# Autodesk Inventor assembly: pl_v1
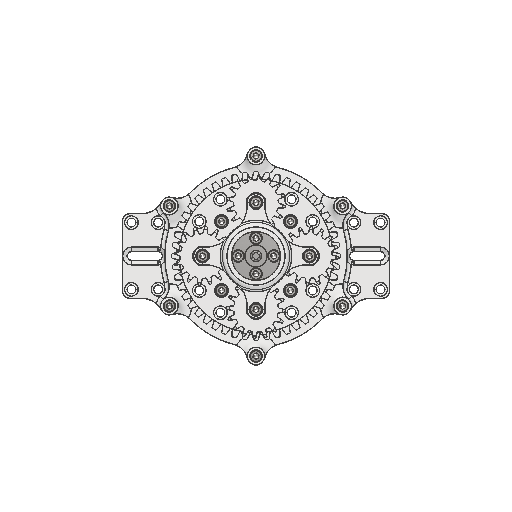
[picture p0: Inventor's stored thumbnail of the model, 512x512]
Saved by Autodesk Inventor 2027 (Build 310192000, 192)
## iProperties
Created: 2026-03-26
Part Number: pl_v1
Document SubType Name: Assembly
Designer: work
Mass: 713.416 g
Surface Area: 800.721 cm^2
Volume: 179.506 cm^3
Density: 3.97433 g/cm^3
Author: work
## Documents named in this file (13)
- C:\Users\khw\Desktop\ARD_v1\ARD_hardware\PL121248m2Drive_v2\pl_v1.iam
- C:\Users\khw\Desktop\ARD_v1\ARD_hardware\PL121248m2Drive_v2\gear_M1.5_Z16_H10.0_spur (1).ipt
- C:\Users\khw\Desktop\ARD_v1\ARD_hardware\PL121248m2Drive_v2\gear_M1.5_Z16_H10.0_spur.ipt
- C:\Users\khw\Desktop\ARD_v1\ARD_hardware\PL121248m2Drive_v2\gear_M1.5_Z48_H10.0_spur.ipt
- C:\Users\khw\Desktop\ARD_v1\ARD_hardware\PL121248m2Drive_v2\KS B 1003 - M 3 x 10.ipt
- C:\Users\khw\Desktop\ARD_v1\ARD_hardware\PL121248m2Drive_v2\NEMA17.ipt
- C:\Users\khw\Desktop\ARD_v1\ARD_hardware\PL121248m2Drive_v2\roter.ipt
- C:\Users\khw\Desktop\ARD_v1\ARD_hardware\PL121248m2Drive_v2\case.ipt
- C:\Users\khw\Desktop\ARD_v1\ARD_hardware\PL121248m2Drive_v2\KS B 1003 - M 3 x 12.ipt
- C:\Users\khw\Desktop\ARD_v1\ARD_hardware\ARD_Model_v1\KS B 2023 - 693 - 3 x 8 x 3 - 0.293.ipt
- C:\Users\khw\Desktop\ARD_v1\ARD_hardware\ARD_Model_v1\KS B 2023 - 6906 - 30 x 47 x 9 - 7.868.ipt
- C:\Users\khw\Desktop\ARD_v1\ARD_hardware\PL121248m2Drive_v2\5_Co.ipt
- C:\Users\khw\Desktop\ARD_v1\ARD_hardware\PL121248m2Drive_v2\5pi40pin.ipt
## Components (40 placed, 12 different names)
1. gear_M1.5_Z16_H10.0_spur (1):1 — 플러쉬:1, 메이트:10, 회전:2, 회전:10, 메이트:19, 메이트:20, 회전:6
2. gear_M1.5_Z16_H10.0_spur:1 — 플러쉬:2, 메이트:4, 메이트:11, 회전:2, 회전:4
3. gear_M1.5_Z48_H10.0_spur:1 — 메이트:1, 메이트:2, 메이트:3, 회전:1, 플러쉬:1, 플러쉬:2, 메이트:16, 각도:1, 플러쉬:3, 플러쉬:4, 플러쉬:5, 메이트:30, 메이트:32, 메이트:33, 각도:2
4. NEMA17:1 — 메이트:1, 메이트:2, 메이트:3, 메이트:4, 메이트:18
5. case:1 — 메이트:16, 메이트:17, 회전:5, 회전:6, 회전:8, 회전:9, 강체:1, 메이트:30, 메이트:32, 메이트:33, 삽입:1, 삽입:6, 삽입:7, 삽입:8, 삽입:9, 삽입:10
6. roter:1 — 메이트:10, 메이트:11, 회전:4, 메이트:17, 각도:1, 메이트:18, 회전:11, 메이트:20, 메이트:24, 메이트:25, 메이트:26, 플러쉬:6, 플러쉬:7, 플러쉬:8, 메이트:27, 메이트:28, 메이트:34, 메이트:35, 메이트:36, 메이트:38, 각도:2, 회전:5, 회전:6, 회전:7, 회전:8
7. KS B 2023 - 693 - 3 x 8 x 3 - 0.293:1 — 회전:10
8. KS B 1003 - M 3 x 12:7 — 회전:11, 메이트:19
9. gear_M1.5_Z16_H10.0_spur (1):2 — 플러쉬:5, 회전:7
10. KS B 2023 - 693 - 3 x 8 x 3 - 0.293:2
11. KS B 1003 - M 3 x 12:8 — 메이트:24, 플러쉬:7
12. gear_M1.5_Z16_H10.0_spur (1):3 — 플러쉬:3, 메이트:25, 회전:8
13. KS B 2023 - 693 - 3 x 8 x 3 - 0.293:3
14. KS B 1003 - M 3 x 12:9 — 플러쉬:6
15. gear_M1.5_Z16_H10.0_spur (1):4 — 플러쉬:4, 메이트:26, 회전:5
16. KS B 2023 - 693 - 3 x 8 x 3 - 0.293:4
17. KS B 1003 - M 3 x 12:10 — 플러쉬:8
18. KS B 2023 - 6906 - 30 x 47 x 9 - 7.868:1 — 메이트:27, 메이트:28
19. 5_Co:1 — 메이트:34, 메이트:35, 메이트:36, 메이트:37, 삽입:2, 삽입:3, 삽입:4, 삽입:5
20. 5pi40pin:1 — 메이트:37, 메이트:38
21. KS B 1003 - M 3 x 12:11 — 삽입:1
22. KS B 1003 - M 3 x 12:12 — 삽입:2
23. KS B 1003 - M 3 x 12:13 — 삽입:3
24. KS B 1003 - M 3 x 12:14 — 삽입:4
25. KS B 1003 - M 3 x 12:15 — 삽입:5
26. KS B 1003 - M 3 x 12:16
27. KS B 1003 - M 3 x 12:17 — 삽입:6
28. KS B 1003 - M 3 x 12:18 — 삽입:7
29. KS B 1003 - M 3 x 12:19 — 삽입:8
30. KS B 1003 - M 3 x 12:20 — 삽입:9
31. KS B 1003 - M 3 x 12:21 — 삽입:10
32. KS B 1003 - M 3 x 12:1 — 회전:5
33. KS B 1003 - M 3 x 12:3 — 회전:9
34. KS B 1003 - M 3 x 12:4 — 회전:8
35. KS B 1003 - M 3 x 12:5 — 회전:6
36. KS B 1003 - M 3 x 12:6 — 강체:1
37. KS B 1003 - 미터 M 3 x 10:1 — 회전:1
38. KS B 1003 - 미터 M 3 x 10:2
39. KS B 1003 - 미터 M 3 x 10:3
40. KS B 1003 - 미터 M 3 x 10:4
## Component patterns: (4 elements, first: KS B 1003 - 미터 M 3 x 10:1)
## Relationships (64: Mate 27, RevoluteJoint 10, Insert 10, Flush 8, RelateRotation 6, Angle 2, WeldJoint 1)
- 메이트:1 [Mate]: gear_M1.5_Z48_H10.0_spur:1 ↔ NEMA17:1
- 메이트:2 [Mate]: gear_M1.5_Z48_H10.0_spur:1 ↔ NEMA17:1
- 메이트:3 [Mate]: gear_M1.5_Z48_H10.0_spur:1 ↔ NEMA17:1
- 회전:1 [RevoluteJoint]: gear_M1.5_Z48_H10.0_spur:1 ↔ KS B 1003 - 미터 M 3 x 10:1
- 플러쉬:1 [Flush]: gear_M1.5_Z16_H10.0_spur (1):1 ↔ gear_M1.5_Z48_H10.0_spur:1
- 플러쉬:2 [Flush]: gear_M1.5_Z16_H10.0_spur:1 ↔ gear_M1.5_Z48_H10.0_spur:1
- 메이트:4 [Mate]: gear_M1.5_Z16_H10.0_spur:1 ↔ NEMA17:1
- 메이트:10 [Mate]: gear_M1.5_Z16_H10.0_spur (1):1 ↔ roter:1
- 메이트:11 [Mate]: gear_M1.5_Z16_H10.0_spur:1 ↔ roter:1
- 회전:2 [RelateRotation] (1 ul): gear_M1.5_Z16_H10.0_spur (1):1 ↔ gear_M1.5_Z16_H10.0_spur:1
- 회전:4 [RelateRotation] (0.25 ul): gear_M1.5_Z16_H10.0_spur:1 ↔ roter:1
- 메이트:16 [Mate]: gear_M1.5_Z48_H10.0_spur:1 ↔ case:1
- 메이트:17 [Mate]: case:1 ↔ roter:1
- 회전:5 [RevoluteJoint]: case:1 ↔ KS B 1003 - M 3 x 12:1
- 회전:6 [RevoluteJoint]: case:1 ↔ KS B 1003 - M 3 x 12:5
- 회전:8 [RevoluteJoint]: case:1 ↔ KS B 1003 - M 3 x 12:4
- 회전:9 [RevoluteJoint]: case:1 ↔ KS B 1003 - M 3 x 12:3
- 강체:1 [WeldJoint]: case:1 ↔ KS B 1003 - M 3 x 12:6
- 각도:1 [Angle] (720 deg): gear_M1.5_Z48_H10.0_spur:1 ↔ roter:1
- 회전:10 [RevoluteJoint]: gear_M1.5_Z16_H10.0_spur (1):1 ↔ KS B 2023 - 693 - 3 x 8 x 3 - 0.293:1
- 메이트:18 [Mate]: NEMA17:1 ↔ roter:1
- 회전:11 [RevoluteJoint]: roter:1 ↔ KS B 1003 - M 3 x 12:7
- 메이트:19 [Mate]: gear_M1.5_Z16_H10.0_spur (1):1 ↔ KS B 1003 - M 3 x 12:7
- 메이트:20 [Mate]: gear_M1.5_Z16_H10.0_spur (1):1 ↔ roter:1
- [RevoluteJoint]: gear_M1.5_Z16_H10.0_spur (1):2 ↔ KS B 2023 - 693 - 3 x 8 x 3 - 0.293:2
- [Mate]: gear_M1.5_Z16_H10.0_spur (1):2 ↔ KS B 1003 - M 3 x 12:8
- [RevoluteJoint]: gear_M1.5_Z16_H10.0_spur (1):3 ↔ KS B 2023 - 693 - 3 x 8 x 3 - 0.293:3
- [Mate]: gear_M1.5_Z16_H10.0_spur (1):3 ↔ KS B 1003 - M 3 x 12:9
- [RevoluteJoint]: gear_M1.5_Z16_H10.0_spur (1):4 ↔ KS B 2023 - 693 - 3 x 8 x 3 - 0.293:4
- [Mate]: gear_M1.5_Z16_H10.0_spur (1):4 ↔ KS B 1003 - M 3 x 12:10
- 플러쉬:3 [Flush]: gear_M1.5_Z48_H10.0_spur:1 ↔ gear_M1.5_Z16_H10.0_spur (1):3
- 플러쉬:4 [Flush]: gear_M1.5_Z48_H10.0_spur:1 ↔ gear_M1.5_Z16_H10.0_spur (1):4
- 플러쉬:5 [Flush]: gear_M1.5_Z48_H10.0_spur:1 ↔ gear_M1.5_Z16_H10.0_spur (1):2
- 메이트:24 [Mate]: roter:1 ↔ KS B 1003 - M 3 x 12:8
- 메이트:25 [Mate]: roter:1 ↔ gear_M1.5_Z16_H10.0_spur (1):3
- 메이트:26 [Mate]: roter:1 ↔ gear_M1.5_Z16_H10.0_spur (1):4
- 플러쉬:6 [Flush]: roter:1 ↔ KS B 1003 - M 3 x 12:9
- 플러쉬:7 [Flush]: roter:1 ↔ KS B 1003 - M 3 x 12:8
- 플러쉬:8 [Flush]: roter:1 ↔ KS B 1003 - M 3 x 12:10
- 메이트:27 [Mate]: roter:1 ↔ KS B 2023 - 6906 - 30 x 47 x 9 - 7.868:1
- 메이트:28 [Mate] (1 mm): roter:1 ↔ KS B 2023 - 6906 - 30 x 47 x 9 - 7.868:1
- 메이트:30 [Mate]: gear_M1.5_Z48_H10.0_spur:1 ↔ case:1
- 메이트:32 [Mate]: gear_M1.5_Z48_H10.0_spur:1 ↔ case:1
- 메이트:33 [Mate]: gear_M1.5_Z48_H10.0_spur:1 ↔ case:1
- 메이트:34 [Mate]: roter:1 ↔ 5_Co:1
- 메이트:35 [Mate]: roter:1 ↔ 5_Co:1
- 메이트:36 [Mate]: roter:1 ↔ 5_Co:1
- 메이트:37 [Mate]: 5_Co:1 ↔ 5pi40pin:1
- 메이트:38 [Mate]: roter:1 ↔ 5pi40pin:1
- 삽입:1 [Insert]: case:1 ↔ KS B 1003 - M 3 x 12:11
- 삽입:2 [Insert]: 5_Co:1 ↔ KS B 1003 - M 3 x 12:12
- 삽입:3 [Insert]: 5_Co:1 ↔ KS B 1003 - M 3 x 12:13
- 삽입:4 [Insert]: 5_Co:1 ↔ KS B 1003 - M 3 x 12:14
- 삽입:5 [Insert]: 5_Co:1 ↔ KS B 1003 - M 3 x 12:15
- 각도:2 [Angle] (0 deg): gear_M1.5_Z48_H10.0_spur:1 ↔ roter:1
- 삽입:6 [Insert]: case:1 ↔ KS B 1003 - M 3 x 12:17
- 삽입:7 [Insert]: case:1 ↔ KS B 1003 - M 3 x 12:18
- 삽입:8 [Insert]: case:1 ↔ KS B 1003 - M 3 x 12:19
- 삽입:9 [Insert]: case:1 ↔ KS B 1003 - M 3 x 12:20
- 삽입:10 [Insert]: case:1 ↔ KS B 1003 - M 3 x 12:21
- 회전:5 [RelateRotation] (1 ul): roter:1 ↔ gear_M1.5_Z16_H10.0_spur (1):4
- 회전:6 [RelateRotation] (1 ul): gear_M1.5_Z16_H10.0_spur (1):1 ↔ roter:1
- 회전:7 [RelateRotation] (1 ul): roter:1 ↔ gear_M1.5_Z16_H10.0_spur (1):2
- 회전:8 [RelateRotation] (1 ul): roter:1 ↔ gear_M1.5_Z16_H10.0_spur (1):3
## Named parameters: d65_d63 = 0 mm, d66_d58 = 0 mm, d67_d59 = -3.06307 deg, d68_d63 = 0 mm, d69_d58 = 0 mm, d70_d59 = 15.336439 deg, d71_d63 = 0 mm, d72_d58 = 0 mm, d73_d59 = 106.253664 deg
